# Autodesk Inventor assembly: ESP32_Assembly
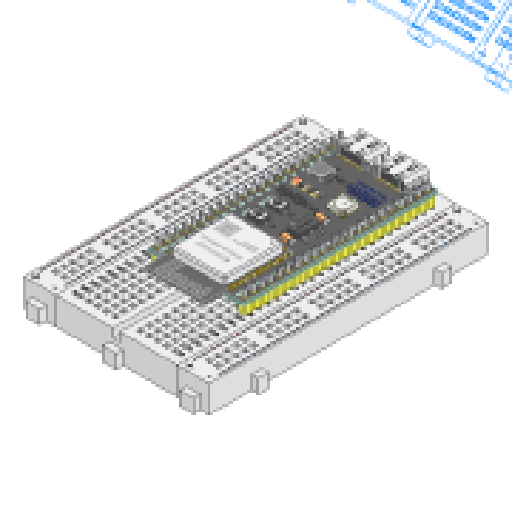
[picture p0: Inventor's stored thumbnail of the model, 512x512]
Saved by Autodesk Inventor 2025 (Build 290162000, 162)
## iProperties
Created: 2024-11-14
Part Number: ESP32_Assembly
Document SubType Name: Assembly
Designer: OSB
Mass: 111.106 g
Surface Area: 277.38 cm^2
Volume: 37.3403 cm^3
Sending System: Autodesk Inventor 2021
Preprocessor: unknown
Minimum Resolution: 0.01
Sent Units: Millimeter
Translation Standard: IGES 5.3
Model Creation Time: 2020-07-07
Title: S500 Frame
Author: OSB
## Documents named in this file (3)
- C:\Users\OSB\Desktop\SB\1.Projects\캡스톤 디자인(2)_Paper\Modeling\Implementation_Design\Ver_004_mass_update\ESP32_Assembly.iam
- C:\Users\OSB\Desktop\SB\1.Projects\캡스톤 디자인(2)_Paper\Modeling\Implementation_Design\Ver_004_mass_update\Breadboard_400.ipt
- C:\Users\OSB\Desktop\SB\1.Projects\캡스톤 디자인(2)_Paper\Modeling\Implementation_Design\Ver_004_mass_update\ESP32.ipt
## Components (2 placed, 2 different names)
1. Breadboard_400:1 — 메이트:1, 메이트:2, 메이트:3
2. ESP32:1 — 메이트:1, 메이트:2, 메이트:3
## Relationships (3: Mate 3)
- 메이트:1 [Mate] (0.075 mm): Breadboard_400:1 ↔ ESP32:1
- 메이트:2 [Mate] (0.075 mm): Breadboard_400:1 ↔ ESP32:1
- 메이트:3 [Mate]: Breadboard_400:1 ↔ ESP32:1
